# Autodesk Inventor assembly: CB_V1
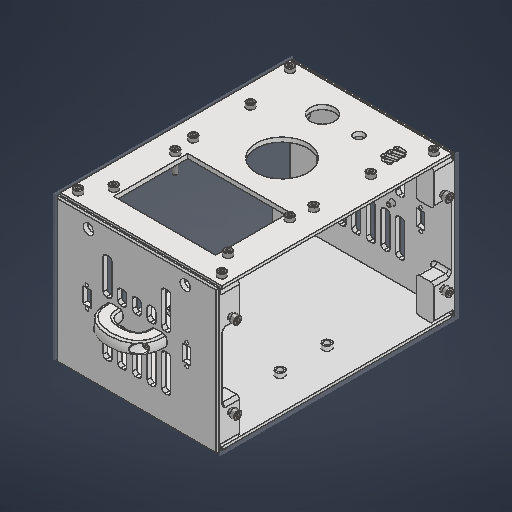
[picture p0: Inventor's stored thumbnail of the model, 512x512]
Saved by Autodesk Inventor 2026.2 (Build 302298010, 298A)
## iProperties
Created: 2026-05-12
Part Number: CB_V1
Document SubType Name: Assembly
Designer: work
Author: work
## Documents named in this file (7)
- C:\Users\work\Desktop\ARD_v1\ARD_hardware\Control Box_v1\CB_V1.iam
- C:\Users\work\Desktop\ARD_v1\ARD_hardware\Control Box_v1\side.ipt
- C:\Users\work\Desktop\ARD_v1\ARD_hardware\Control Box_v1\top.ipt
- C:\Users\work\Desktop\ARD_v1\ARD_hardware\Control Box_v1\BACK.ipt
- C:\Users\work\Desktop\ARD_v1\ARD_hardware\Control Box_v1\bottom.ipt
- C:\Users\work\Desktop\ARD_v1\ARD_hardware\Control Box_v1\KS B 1003 - M 3 x 12.ipt
- C:\Users\work\Desktop\ARD_v1\ARD_hardware\Control Box_v1\U-volt.ipt
## Components (36 placed, 6 different names)
1. side:1 — 메이트:1, 메이트:2, 메이트:3, 메이트:8, 메이트:9, 메이트:10, 메이트:13, 메이트:17, 메이트:18, 메이트:19, 메이트:22
2. top:1 — 메이트:10, 메이트:11, 메이트:12, 삽입:5, 삽입:6, 삽입:7, 삽입:8, 삽입:9, 삽입:10, 삽입:11, 삽입:12, 삽입:13, 삽입:14, 삽입:15, 삽입:16
3. BACK:1 — 메이트:8, 메이트:9, 메이트:13, 삽입:1, 삽입:2, 삽입:3, 삽입:4
4. bottom:1 — 메이트:1, 메이트:2, 메이트:3, 메이트:4, 메이트:5, 메이트:6, 삽입:19, 삽입:20, 삽입:21, 삽입:22
5. KS B 1003 - M 3 x 12:1 — 삽입:1
6. side:2 — 메이트:4, 메이트:5, 메이트:6, 메이트:11, 메이트:12, 메이트:14, 메이트:15, 메이트:16, 메이트:20, 메이트:21
7. U-volt:1 — 메이트:14, 메이트:15, 메이트:16, 삽입:23, 삽입:24
8. U-volt:2 — 메이트:17, 메이트:18, 메이트:19, 삽입:17, 삽입:18
9. KS B 1003 - M 3 x 12:2 — 삽입:2
10. KS B 1003 - M 3 x 12:3 — 삽입:3
11. KS B 1003 - M 3 x 12:4 — 삽입:4
12. KS B 1003 - M 3 x 12:5 — 삽입:5
13. KS B 1003 - M 3 x 12:6 — 삽입:6
14. KS B 1003 - M 3 x 12:7 — 삽입:7
15. KS B 1003 - M 3 x 12:8 — 삽입:8
16. KS B 1003 - M 3 x 12:9 — 삽입:9
17. KS B 1003 - M 3 x 12:10 — 삽입:10
18. KS B 1003 - M 3 x 12:11 — 삽입:11
19. KS B 1003 - M 3 x 12:12 — 삽입:12
20. KS B 1003 - M 3 x 12:13 — 삽입:13
21. KS B 1003 - M 3 x 12:14 — 삽입:14
22. KS B 1003 - M 3 x 12:15 — 삽입:15
23. KS B 1003 - M 3 x 12:16 — 삽입:16
24. KS B 1003 - M 3 x 12:17 — 삽입:17
25. KS B 1003 - M 3 x 12:18 — 삽입:18
26. KS B 1003 - M 3 x 12:19 — 삽입:19
27. KS B 1003 - M 3 x 12:20 — 삽입:20
28. KS B 1003 - M 3 x 12:21 — 삽입:21
29. KS B 1003 - M 3 x 12:22 — 삽입:22
30. KS B 1003 - M 3 x 12:23 — 삽입:23
31. KS B 1003 - M 3 x 12:24 — 삽입:24
32. BACK:2 — 메이트:20, 메이트:21, 메이트:22, 삽입:25, 삽입:26, 삽입:27, 삽입:28
33. KS B 1003 - M 3 x 12:25 — 삽입:25
34. KS B 1003 - M 3 x 12:26 — 삽입:26
35. KS B 1003 - M 3 x 12:27 — 삽입:27
36. KS B 1003 - M 3 x 12:28 — 삽입:28
## Relationships (49: Insert 28, Mate 21)
- 메이트:1 [Mate]: side:1 ↔ bottom:1
- 메이트:2 [Mate]: side:1 ↔ bottom:1
- 메이트:3 [Mate]: side:1 ↔ bottom:1
- 메이트:4 [Mate]: bottom:1 ↔ side:2
- 메이트:5 [Mate]: bottom:1 ↔ side:2
- 메이트:6 [Mate]: bottom:1 ↔ side:2
- 메이트:8 [Mate]: side:1 ↔ BACK:1
- 메이트:9 [Mate]: side:1 ↔ BACK:1
- 메이트:10 [Mate]: side:1 ↔ top:1
- 메이트:11 [Mate]: top:1 ↔ side:2
- 메이트:12 [Mate]: top:1 ↔ side:2
- 메이트:13 [Mate]: side:1 ↔ BACK:1
- 메이트:14 [Mate]: side:2 ↔ U-volt:1
- 메이트:15 [Mate]: side:2 ↔ U-volt:1
- 메이트:16 [Mate]: side:2 ↔ U-volt:1
- 메이트:17 [Mate]: side:1 ↔ U-volt:2
- 메이트:18 [Mate]: side:1 ↔ U-volt:2
- 메이트:19 [Mate]: side:1 ↔ U-volt:2
- 삽입:1 [Insert]: BACK:1 ↔ KS B 1003 - M 3 x 12:1
- 삽입:2 [Insert]: BACK:1 ↔ KS B 1003 - M 3 x 12:2
- 삽입:3 [Insert]: BACK:1 ↔ KS B 1003 - M 3 x 12:3
- 삽입:4 [Insert]: BACK:1 ↔ KS B 1003 - M 3 x 12:4
- 삽입:5 [Insert]: top:1 ↔ KS B 1003 - M 3 x 12:5
- 삽입:6 [Insert]: top:1 ↔ KS B 1003 - M 3 x 12:6
- 삽입:7 [Insert]: top:1 ↔ KS B 1003 - M 3 x 12:7
- 삽입:8 [Insert]: top:1 ↔ KS B 1003 - M 3 x 12:8
- 삽입:9 [Insert]: top:1 ↔ KS B 1003 - M 3 x 12:9
- 삽입:10 [Insert]: top:1 ↔ KS B 1003 - M 3 x 12:10
- 삽입:11 [Insert]: top:1 ↔ KS B 1003 - M 3 x 12:11
- 삽입:12 [Insert]: top:1 ↔ KS B 1003 - M 3 x 12:12
- 삽입:13 [Insert]: top:1 ↔ KS B 1003 - M 3 x 12:13
- 삽입:14 [Insert]: top:1 ↔ KS B 1003 - M 3 x 12:14
- 삽입:15 [Insert]: top:1 ↔ KS B 1003 - M 3 x 12:15
- 삽입:16 [Insert]: top:1 ↔ KS B 1003 - M 3 x 12:16
- 삽입:17 [Insert]: U-volt:2 ↔ KS B 1003 - M 3 x 12:17
- 삽입:18 [Insert]: U-volt:2 ↔ KS B 1003 - M 3 x 12:18
- 삽입:19 [Insert]: bottom:1 ↔ KS B 1003 - M 3 x 12:19
- 삽입:20 [Insert]: bottom:1 ↔ KS B 1003 - M 3 x 12:20
- 삽입:21 [Insert]: bottom:1 ↔ KS B 1003 - M 3 x 12:21
- 삽입:22 [Insert]: bottom:1 ↔ KS B 1003 - M 3 x 12:22
- 삽입:23 [Insert]: U-volt:1 ↔ KS B 1003 - M 3 x 12:23
- 삽입:24 [Insert]: U-volt:1 ↔ KS B 1003 - M 3 x 12:24
- 메이트:20 [Mate]: side:2 ↔ BACK:2
- 메이트:21 [Mate]: side:2 ↔ BACK:2
- 메이트:22 [Mate]: side:1 ↔ BACK:2
- 삽입:25 [Insert]: BACK:2 ↔ KS B 1003 - M 3 x 12:25
- 삽입:26 [Insert]: BACK:2 ↔ KS B 1003 - M 3 x 12:26
- 삽입:27 [Insert]: BACK:2 ↔ KS B 1003 - M 3 x 12:27
- 삽입:28 [Insert]: BACK:2 ↔ KS B 1003 - M 3 x 12:28
